# Autodesk Inventor assembly: ARMADO FINAL
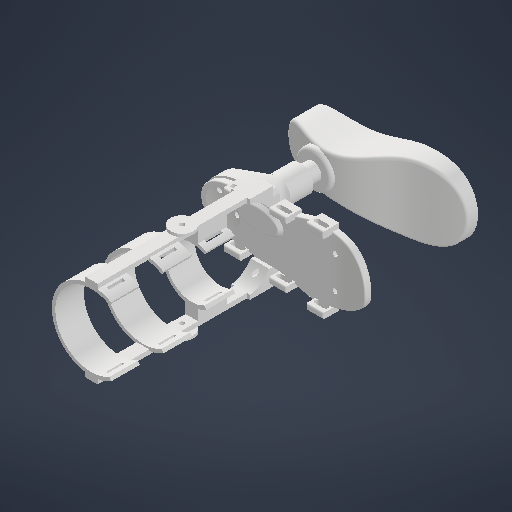
[picture p0: Inventor's stored thumbnail of the model, 512x512]
Saved by Autodesk Inventor 2027.1 (Build 311270010, 270A)
## iProperties
Created: 2026-11-01
Part Number: ARMADO FINAL
Document SubType Name: Assembly
Designer: rodri
Author: rodri
## Documents named in this file (5)
- C:\Users\rodri\Downloads\FunBio\ARMADO FINAL.iam
- C:\Users\rodri\Downloads\FunBio\plataforma_pie_humana_punta_suave.ipt
- C:\Users\rodri\Downloads\FunBio\ortesis_diametros_ajustados.ipt
- C:\Users\rodri\Downloads\FunBio\modulo_medio_cazoleta_pilon.ipt
- C:\Users\rodri\Downloads\FunBio\pilon_superior_10cm_oval.ipt
## Components (4 placed, 4 different names)
1. plataforma_pie_humana_punta_suave:1 — De rotación:2, De rotación:3
2. ortesis_diametros_ajustados:1 — De rotación:2
3. modulo_medio_cazoleta_pilon:1 — De rotación:1
4. pilon_superior_10cm_oval:1 — De rotación:1, De rotación:3
## Relationships (3: RevoluteJoint 3)
- De rotación:1 [RevoluteJoint]: modulo_medio_cazoleta_pilon:1 ↔ pilon_superior_10cm_oval:1
- De rotación:2 [RevoluteJoint]: plataforma_pie_humana_punta_suave:1 ↔ ortesis_diametros_ajustados:1
- De rotación:3 [RevoluteJoint]: plataforma_pie_humana_punta_suave:1 ↔ pilon_superior_10cm_oval:1
